# Autodesk Inventor assembly: Suporte motor Pittman
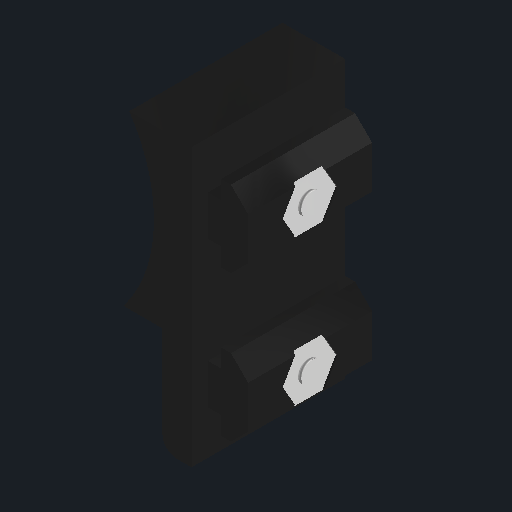
[picture p0: Inventor's stored thumbnail of the model, 512x512]
Saved by Autodesk Inventor 2026.1 (Build 301233000, 233)
## iProperties
Created: 2025-01-15
Part Number: Suporte motor Pittman
Document SubType Name: Assembly
Designer: Cliente
Mass: 7.94839 g
Surface Area: 43.3637 cm^2
Volume: 5.68161 cm^3
Density: 1.39897 g/cm^3
Author: Cliente
## Documents named in this file (4)
- C:\Users\Cliente\Desktop\TCC\Base\Motor\Suporte motor Pittman.iam
- C:\Users\Cliente\Desktop\TCC\Base\Impresso\Suporte motor Pittman.ipt
- C:\Users\Cliente\Desktop\TCC\Fixação\Porca perfil de alumínio.iam
- C:\Users\Cliente\Desktop\TCC\Fixação\Parafuso 2,9 x 8mm.ipt
## Components (5 placed, 3 different names)
1. Suporte motor Pittman:1 — Alinhado:1, Alinhado:2, Alinhado:3, Coincidente:1, Coincidente:2, Coincidente:3, Coincidente:4, Ângulo:1, Ângulo:2, Coincidente:5, Coincidente:6, Ângulo:3, Ângulo:4
2. Porca perfil de alumínio:1 [sub-assembly] — Coincidente:1, Coincidente:3, Ângulo:2, Coincidente:7
3. Porca perfil de alumínio:2 [sub-assembly] — Coincidente:2, Coincidente:4, Ângulo:1, Coincidente:8
4. Parafuso 2,9 x 8mm:1 — Coincidente:6, Coincidente:8, Ângulo:3
5. Parafuso 2,9 x 8mm:2 — Coincidente:5, Coincidente:7, Ângulo:4
## Relationships (15: Mate 8, Angle 4, Flush 3)
- Alinhado:1 [Flush]: Suporte motor Pittman:1
- Alinhado:2 [Flush]: Suporte motor Pittman:1
- Alinhado:3 [Flush]: Suporte motor Pittman:1
- Coincidente:1 [Mate] (0.25 mm): Suporte motor Pittman:1 ↔ Porca perfil de alumínio:1
- Coincidente:2 [Mate] (0.25 mm): Suporte motor Pittman:1 ↔ Porca perfil de alumínio:2
- Coincidente:3 [Mate]: Suporte motor Pittman:1 ↔ Porca perfil de alumínio:1
- Coincidente:4 [Mate]: Suporte motor Pittman:1 ↔ Porca perfil de alumínio:2
- Ângulo:1 [Angle] (0 deg): Suporte motor Pittman:1 ↔ Porca perfil de alumínio:2
- Ângulo:2 [Angle] (0 deg): Suporte motor Pittman:1 ↔ Porca perfil de alumínio:1
- Coincidente:5 [Mate]: Suporte motor Pittman:1 ↔ Parafuso 2,9 x 8mm:2
- Coincidente:6 [Mate]: Suporte motor Pittman:1 ↔ Parafuso 2,9 x 8mm:1
- Coincidente:7 [Mate]: Porca perfil de alumínio:1 ↔ Parafuso 2,9 x 8mm:2
- Coincidente:8 [Mate]: Porca perfil de alumínio:2 ↔ Parafuso 2,9 x 8mm:1
- Ângulo:3 [Angle] (0 deg): Suporte motor Pittman:1 ↔ Parafuso 2,9 x 8mm:1
- Ângulo:4 [Angle] (0 deg): Suporte motor Pittman:1 ↔ Parafuso 2,9 x 8mm:2
